# Autodesk Inventor assembly: 24-10-25-project-1-Lawrence-A2213271
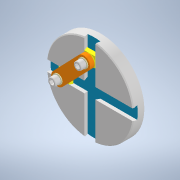
[picture p0: Inventor's stored thumbnail of the model, 180x180]
Saved by Autodesk Inventor 2022 (Build 260153000, 153)
## iProperties
Created: 2024-10-26
Part Number: 24-10-25-project-1-Lawrence-A2213271
Document SubType Name: Assembly
Designer: Dell
Author: Dell
## Documents named in this file (6)
- C:\Users\Dell\Desktop\sliding assembly\24-10-25-project-1-Lawrence-A2213271.iam
- C:\Users\Dell\Desktop\sliding assembly\24-10-25-base-Lawrence-A2213271-v1.ipt
- C:\Users\Dell\Desktop\sliding assembly\24-10-25-link-Lawrence-A2213271-v1.ipt
- C:\Users\Dell\Desktop\sliding assembly\24-10-25-slider-Lawrence-A2213271-v1.ipt
- C:\Users\Dell\Desktop\sliding assembly\24-10-25-washer-Lawrence-A2213271-v1.ipt
- C:\Users\Dell\Desktop\sliding assembly\24-10-25-bolt-Lawrence-A2213271-v1.ipt
## Components (10 placed, 5 different names)
1. 24-10-25-base-Lawrence-A2213271-v1:1 — Mate:1, Mate:2, Mate:3, Mate:4
2. 24-10-25-link-Lawrence-A2213271-v1:1 — Mate:9, Mate:10, Mate:11, Mate:12, Mate:13, Mate:14, Mate:15
3. 24-10-25-slider-Lawrence-A2213271-v1:1 — Mate:1, Mate:3, Mate:5, Mate:6
4. 24-10-25-slider-Lawrence-A2213271-v1:2 — Mate:2, Mate:4, Mate:7, Mate:8
5. 24-10-25-washer-Lawrence-A2213271-v1:1 — Mate:7, Mate:8, Mate:9, Mate:11
6. 24-10-25-washer-Lawrence-A2213271-v1:2 — Mate:5, Mate:6, Mate:10
7. 24-10-25-bolt-Lawrence-A2213271-v1:1 — Mate:17, Mate:19
8. 24-10-25-bolt-Lawrence-A2213271-v1:2 — Mate:16, Mate:18
9. 24-10-25-washer-Lawrence-A2213271-v1:3 — Mate:12, Mate:13, Mate:16, Mate:18
10. 24-10-25-washer-Lawrence-A2213271-v1:4 — Mate:14, Mate:15, Mate:17, Mate:19
## Relationships (19: Mate 19)
- Mate:1: 24-10-25-base-Lawrence-A2213271-v1:1 ↔ 24-10-25-slider-Lawrence-A2213271-v1:1
- Mate:2: 24-10-25-base-Lawrence-A2213271-v1:1 ↔ 24-10-25-slider-Lawrence-A2213271-v1:2
- Mate:3: 24-10-25-base-Lawrence-A2213271-v1:1 ↔ 24-10-25-slider-Lawrence-A2213271-v1:1
- Mate:4: 24-10-25-base-Lawrence-A2213271-v1:1 ↔ 24-10-25-slider-Lawrence-A2213271-v1:2
- Mate:5: 24-10-25-slider-Lawrence-A2213271-v1:1 ↔ 24-10-25-washer-Lawrence-A2213271-v1:2
- Mate:6: 24-10-25-slider-Lawrence-A2213271-v1:1 ↔ 24-10-25-washer-Lawrence-A2213271-v1:2
- Mate:7: 24-10-25-slider-Lawrence-A2213271-v1:2 ↔ 24-10-25-washer-Lawrence-A2213271-v1:1
- Mate:8: 24-10-25-slider-Lawrence-A2213271-v1:2 ↔ 24-10-25-washer-Lawrence-A2213271-v1:1
- Mate:9: 24-10-25-link-Lawrence-A2213271-v1:1 ↔ 24-10-25-washer-Lawrence-A2213271-v1:1
- Mate:10: 24-10-25-link-Lawrence-A2213271-v1:1 ↔ 24-10-25-washer-Lawrence-A2213271-v1:2
- Mate:11: 24-10-25-link-Lawrence-A2213271-v1:1 ↔ 24-10-25-washer-Lawrence-A2213271-v1:1
- Mate:12: 24-10-25-link-Lawrence-A2213271-v1:1 ↔ 24-10-25-washer-Lawrence-A2213271-v1:3
- Mate:13: 24-10-25-link-Lawrence-A2213271-v1:1 ↔ 24-10-25-washer-Lawrence-A2213271-v1:3
- Mate:14: 24-10-25-link-Lawrence-A2213271-v1:1 ↔ 24-10-25-washer-Lawrence-A2213271-v1:4
- Mate:15: 24-10-25-link-Lawrence-A2213271-v1:1 ↔ 24-10-25-washer-Lawrence-A2213271-v1:4
- Mate:16: 24-10-25-bolt-Lawrence-A2213271-v1:2 ↔ 24-10-25-washer-Lawrence-A2213271-v1:3
- Mate:17: 24-10-25-bolt-Lawrence-A2213271-v1:1 ↔ 24-10-25-washer-Lawrence-A2213271-v1:4
- Mate:18: 24-10-25-bolt-Lawrence-A2213271-v1:2 ↔ 24-10-25-washer-Lawrence-A2213271-v1:3
- Mate:19: 24-10-25-bolt-Lawrence-A2213271-v1:1 ↔ 24-10-25-washer-Lawrence-A2213271-v1:4
